# Autodesk Inventor assembly: Baugruppe1
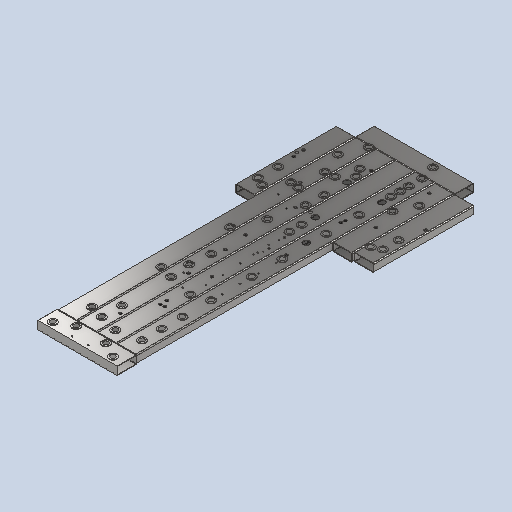
[picture p0: Inventor's stored thumbnail of the model, 512x512]
Saved by Autodesk Inventor 2027.1 (Build 311270010, 270A)
## iProperties
Created: 2026-07-23
Part Number: Baugruppe1
Document SubType Name: Assembly
Designer: Leander
Author: Leander
## Documents named in this file (3)
- C:\Users\moest\Downloads\Gesamtprojekt\Biegelehre (Gesamtpr.)\Baugruppe1.iam
- C:\Users\moest\Downloads\Gesamtprojekt\Biegelehre (Gesamtpr.)\Bauteil1.ipt
- C:\Users\moest\Downloads\Gesamtprojekt\Biegelehre (Gesamtpr.)\Buchse.ipt
## Components (49 placed, 2 different names)
1. Bauteil1:1 — Passend:1, Passend:2, Passend:3, Passend:4, Passend:5, Passend:6, Passend:7, Passend:8, Passend:9, Passend:10, Passend:11, Passend:12, Passend:13, Passend:14, Passend:15, Passend:16, Passend:17, Passend:18, Passend:19, Passend:20, Passend:21, Passend:22, Passend:23, Passend:24, Passend:25, Passend:26, Passend:27, Passend:28, Passend:29, Passend:30, Passend:31, Passend:32, Passend:33, Passend:34, Passend:35, Passend:36, Passend:37, Passend:38, Passend:39, Passend:40, Passend:41, Passend:42, Passend:43, Passend:44, Passend:45, Passend:46, Passend:47, Passend:48, Passend:49, Passend:50, Passend:51, Passend:52, Passend:53, Passend:54, Passend:55, Passend:56, Passend:57, Passend:58, Passend:59, Passend:60, Passend:61, Passend:62, Passend:63, Passend:64, Passend:65, Passend:66, Passend:67, Passend:68, Passend:69, Passend:70, Passend:71, Passend:72, Passend:73, Passend:74, Passend:75, Passend:76, Passend:77, Passend:78, Passend:79, Passend:80, Passend:81, Passend:82, Passend:83, Passend:84, Passend:85, Passend:86, Passend:87, Passend:88, Passend:89, Passend:90, Passend:91, Passend:92, Passend:93, Passend:94, Passend:95, Passend:96
2. Buchse:1 — Passend:1, Passend:2
3. Buchse:2 — Passend:3, Passend:4
4. Buchse:3 — Passend:5, Passend:6
5. Buchse:4 — Passend:7, Passend:35
6. Buchse:5 — Passend:8, Passend:37
7. Buchse:6 — Passend:13, Passend:34
8. Buchse:7 — Passend:14, Passend:41
9. Buchse:8 — Passend:9, Passend:39
10. Buchse:9 — Passend:10, Passend:38
11. Buchse:10 — Passend:11, Passend:36
12. Buchse:11 — Passend:12, Passend:40
13. Buchse:12 — Passend:15, Passend:42
14. Buchse:13 — Passend:18, Passend:49
15. Buchse:14 — Passend:16, Passend:43
16. Buchse:15 — Passend:17, Passend:50
17. Buchse:16 — Passend:19, Passend:48
18. Buchse:17 — Passend:20, Passend:51
19. Buchse:18 — Passend:21, Passend:52
20. Buchse:19 — Passend:26, Passend:55
21. Buchse:20 — Passend:23, Passend:53
22. Buchse:21 — Passend:22, Passend:47
23. Buchse:22 — Passend:25, Passend:54
24. Buchse:23 — Passend:27, Passend:59
25. Buchse:24 — Passend:28, Passend:57
26. Buchse:25 — Passend:24, Passend:56
27. Buchse:26 — Passend:29, Passend:58
28. Buchse:27 — Passend:30, Passend:60
29. Buchse:28 — Passend:31, Passend:44
30. Buchse:29 — Passend:32, Passend:46
31. Buchse:30 — Passend:33, Passend:45
32. Buchse:31 — Passend:63, Passend:96
33. Buchse:32 — Passend:67, Passend:90
34. Buchse:33 — Passend:64, Passend:93
35. Buchse:34 — Passend:68, Passend:89
36. Buchse:35 — Passend:65, Passend:92
37. Buchse:36 — Passend:69, Passend:88
38. Buchse:37 — Passend:70, Passend:87
39. Buchse:38 — Passend:61, Passend:95
40. Buchse:39 — Passend:62, Passend:94
41. Buchse:40 — Passend:66, Passend:91
42. Buchse:41 — Passend:71, Passend:86
43. Buchse:42 — Passend:72, Passend:85
44. Buchse:43 — Passend:73, Passend:83
45. Buchse:44 — Passend:74, Passend:84
46. Buchse:45 — Passend:75, Passend:82
47. Buchse:46 — Passend:76, Passend:81
48. Buchse:47 — Passend:77, Passend:80
49. Buchse:48 — Passend:78, Passend:79
## Relationships (96: Mate 96)
- Passend:1 [Mate]: Bauteil1:1 ↔ Buchse:1
- Passend:2 [Mate]: Bauteil1:1 ↔ Buchse:1
- Passend:3 [Mate]: Bauteil1:1 ↔ Buchse:2
- Passend:4 [Mate]: Bauteil1:1 ↔ Buchse:2
- Passend:5 [Mate]: Bauteil1:1 ↔ Buchse:3
- Passend:6 [Mate]: Bauteil1:1 ↔ Buchse:3
- Passend:7 [Mate]: Bauteil1:1 ↔ Buchse:4
- Passend:8 [Mate]: Bauteil1:1 ↔ Buchse:5
- Passend:9 [Mate]: Bauteil1:1 ↔ Buchse:8
- Passend:10 [Mate]: Bauteil1:1 ↔ Buchse:9
- Passend:11 [Mate]: Bauteil1:1 ↔ Buchse:10
- Passend:12 [Mate]: Bauteil1:1 ↔ Buchse:11
- Passend:13 [Mate]: Bauteil1:1 ↔ Buchse:6
- Passend:14 [Mate]: Bauteil1:1 ↔ Buchse:7
- Passend:15 [Mate]: Bauteil1:1 ↔ Buchse:12
- Passend:16 [Mate]: Bauteil1:1 ↔ Buchse:14
- Passend:17 [Mate]: Bauteil1:1 ↔ Buchse:15
- Passend:18 [Mate]: Bauteil1:1 ↔ Buchse:13
- Passend:19 [Mate]: Bauteil1:1 ↔ Buchse:16
- Passend:20 [Mate]: Bauteil1:1 ↔ Buchse:17
- Passend:21 [Mate]: Bauteil1:1 ↔ Buchse:18
- Passend:22 [Mate]: Bauteil1:1 ↔ Buchse:21
- Passend:23 [Mate]: Bauteil1:1 ↔ Buchse:20
- Passend:24 [Mate]: Bauteil1:1 ↔ Buchse:25
- Passend:25 [Mate]: Bauteil1:1 ↔ Buchse:22
- Passend:26 [Mate]: Bauteil1:1 ↔ Buchse:19
- Passend:27 [Mate]: Bauteil1:1 ↔ Buchse:23
- Passend:28 [Mate]: Bauteil1:1 ↔ Buchse:24
- Passend:29 [Mate]: Bauteil1:1 ↔ Buchse:26
- Passend:30 [Mate]: Bauteil1:1 ↔ Buchse:27
- Passend:31 [Mate]: Bauteil1:1 ↔ Buchse:28
- Passend:32 [Mate]: Bauteil1:1 ↔ Buchse:29
- Passend:33 [Mate]: Bauteil1:1 ↔ Buchse:30
- Passend:34 [Mate]: Bauteil1:1 ↔ Buchse:6
- Passend:35 [Mate]: Bauteil1:1 ↔ Buchse:4
- Passend:36 [Mate]: Bauteil1:1 ↔ Buchse:10
- Passend:37 [Mate]: Bauteil1:1 ↔ Buchse:5
- Passend:38 [Mate]: Bauteil1:1 ↔ Buchse:9
- Passend:39 [Mate]: Bauteil1:1 ↔ Buchse:8
- Passend:40 [Mate]: Bauteil1:1 ↔ Buchse:11
- Passend:41 [Mate]: Bauteil1:1 ↔ Buchse:7
- Passend:42 [Mate]: Bauteil1:1 ↔ Buchse:12
- Passend:43 [Mate]: Bauteil1:1 ↔ Buchse:14
- Passend:44 [Mate]: Bauteil1:1 ↔ Buchse:28
- Passend:45 [Mate]: Bauteil1:1 ↔ Buchse:30
- Passend:46 [Mate]: Bauteil1:1 ↔ Buchse:29
- Passend:47 [Mate]: Bauteil1:1 ↔ Buchse:21
- Passend:48 [Mate]: Bauteil1:1 ↔ Buchse:16
- Passend:49 [Mate]: Bauteil1:1 ↔ Buchse:13
- Passend:50 [Mate]: Bauteil1:1 ↔ Buchse:15
- Passend:51 [Mate]: Bauteil1:1 ↔ Buchse:17
- Passend:52 [Mate]: Bauteil1:1 ↔ Buchse:18
- Passend:53 [Mate]: Bauteil1:1 ↔ Buchse:20
- Passend:54 [Mate]: Bauteil1:1 ↔ Buchse:22
- Passend:55 [Mate]: Bauteil1:1 ↔ Buchse:19
- Passend:56 [Mate]: Bauteil1:1 ↔ Buchse:25
- Passend:57 [Mate]: Bauteil1:1 ↔ Buchse:24
- Passend:58 [Mate]: Bauteil1:1 ↔ Buchse:26
- Passend:59 [Mate]: Bauteil1:1 ↔ Buchse:23
- Passend:60 [Mate]: Bauteil1:1 ↔ Buchse:27
- Passend:61 [Mate]: Bauteil1:1 ↔ Buchse:38
- Passend:62 [Mate]: Bauteil1:1 ↔ Buchse:39
- Passend:63 [Mate]: Bauteil1:1 ↔ Buchse:31
- Passend:64 [Mate]: Bauteil1:1 ↔ Buchse:33
- Passend:65 [Mate]: Bauteil1:1 ↔ Buchse:35
- Passend:66 [Mate]: Bauteil1:1 ↔ Buchse:40
- Passend:67 [Mate]: Bauteil1:1 ↔ Buchse:32
- Passend:68 [Mate]: Bauteil1:1 ↔ Buchse:34
- Passend:69 [Mate]: Bauteil1:1 ↔ Buchse:36
- Passend:70 [Mate]: Bauteil1:1 ↔ Buchse:37
- Passend:71 [Mate]: Bauteil1:1 ↔ Buchse:41
- Passend:72 [Mate]: Bauteil1:1 ↔ Buchse:42
- Passend:73 [Mate]: Bauteil1:1 ↔ Buchse:43
- Passend:74 [Mate]: Bauteil1:1 ↔ Buchse:44
- Passend:75 [Mate]: Bauteil1:1 ↔ Buchse:45
- Passend:76 [Mate]: Bauteil1:1 ↔ Buchse:46
- Passend:77 [Mate]: Bauteil1:1 ↔ Buchse:47
- Passend:78 [Mate]: Bauteil1:1 ↔ Buchse:48
- Passend:79 [Mate]: Bauteil1:1 ↔ Buchse:48
- Passend:80 [Mate]: Bauteil1:1 ↔ Buchse:47
- Passend:81 [Mate]: Bauteil1:1 ↔ Buchse:46
- Passend:82 [Mate]: Bauteil1:1 ↔ Buchse:45
- Passend:83 [Mate]: Bauteil1:1 ↔ Buchse:43
- Passend:84 [Mate]: Bauteil1:1 ↔ Buchse:44
- Passend:85 [Mate]: Bauteil1:1 ↔ Buchse:42
- Passend:86 [Mate]: Bauteil1:1 ↔ Buchse:41
- Passend:87 [Mate]: Bauteil1:1 ↔ Buchse:37
- Passend:88 [Mate]: Bauteil1:1 ↔ Buchse:36
- Passend:89 [Mate]: Bauteil1:1 ↔ Buchse:34
- Passend:90 [Mate]: Bauteil1:1 ↔ Buchse:32
- Passend:91 [Mate]: Bauteil1:1 ↔ Buchse:40
- Passend:92 [Mate]: Bauteil1:1 ↔ Buchse:35
- Passend:93 [Mate]: Bauteil1:1 ↔ Buchse:33
- Passend:94 [Mate]: Bauteil1:1 ↔ Buchse:39
- Passend:95 [Mate]: Bauteil1:1 ↔ Buchse:38
- Passend:96 [Mate]: Bauteil1:1 ↔ Buchse:31
